# Autodesk Inventor assembly: Assembly1
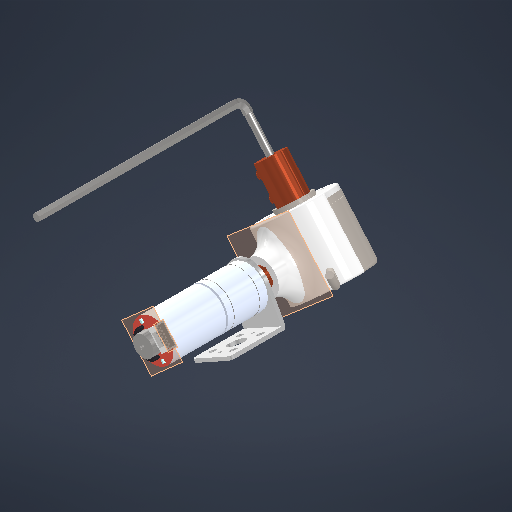
[picture p0: Inventor's stored thumbnail of the model, 512x512]
Saved by Autodesk Inventor 2027 (Build 310192000, 192)
## iProperties
Created: 2026-11-17
Part Number: Assembly1
Document SubType Name: Assembly
Designer: youse
Author: youse
## Documents named in this file (7)
- D:\university new\Modern Control\project\resources\modern control\modern control\Assembly1.iam
- D:\university new\Modern Control\project\resources\modern control\modern control\ROTERY ENCODER.step.ipt
- D:\university new\Modern Control\project\resources\modern control\modern control\Motor.ipt
- D:\university new\Modern Control\project\resources\modern control\modern control\Rigid 6 to 8mm Coupler v2.ipt
- D:\university new\Modern Control\project\resources\modern control\modern control\motor holder.ipt
- D:\university new\Modern Control\project\resources\modern control\modern control\ALLEN_04_mm.ipt
- D:\university new\Modern Control\project\resources\modern control\modern control\Assembly2\Assembly2.iam
## Components (7 placed, 6 different names)
1. ROTERY ENCODER.step:1
2. Motor:1 — Mate:1, Mate:2, Mate:14, Mate:15
3. Rigid 6 to 8mm Coupler v2:1 — Mate:8, Mate:9, Mate:10, Mate:11, Mate:12
4. motor holder:1 — Mate:1, Mate:2
5. ALLEN_04_mm:1 — Mate:10, Mate:11
6. ROTERY ENCODER.step:2 — Mate:8, Mate:9, Mate:13
7. Assembly2:1 [sub-assembly] — Mate:12, Mate:13, Mate:14, Mate:15
## Relationships (10: Mate 10)
- Mate:1: Motor:1 ↔ motor holder:1
- Mate:2: Motor:1 ↔ motor holder:1
- Mate:8: Rigid 6 to 8mm Coupler v2:1 ↔ ROTERY ENCODER.step:2
- Mate:9: Rigid 6 to 8mm Coupler v2:1 ↔ ROTERY ENCODER.step:2
- Mate:10: Rigid 6 to 8mm Coupler v2:1 ↔ ALLEN_04_mm:1
- Mate:11: Rigid 6 to 8mm Coupler v2:1 ↔ ALLEN_04_mm:1
- Mate:12: Rigid 6 to 8mm Coupler v2:1 ↔ Assembly2:1
- Mate:13: ROTERY ENCODER.step:2 ↔ Assembly2:1
- Mate:14: Motor:1 ↔ Assembly2:1
- Mate:15: Motor:1 ↔ Assembly2:1
